# Autodesk Inventor assembly: SPE10V1 Soporte Freno (soldadura)
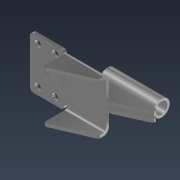
[picture p0: Inventor's stored thumbnail of the model, 180x180]
Saved by Autodesk Inventor 2021.2 (Build 252289000, 289)
## iProperties
Created: 2026-08-04
Part Number: SPE10V1 Soporte Freno (soldadura)
Document SubType Name: Assembly
Designer: nelso
Author: nelso
## Documents named in this file (4)
- C:\Users\Tecnica\OneDrive\Documentos\Mecanica\Soporte-Paciente-Espinografia\Workspace\SPE10V1 Soporte Freno (soldadura).iam
- C:\Users\Tecnica\OneDrive\Documentos\Mecanica\Soporte-Paciente-Espinografia\Workspace\SP32V1 Estructura Freno.ipt
- C:\Users\Tecnica\OneDrive\Documentos\Mecanica\Soporte-Paciente-Espinografia\Workspace\SP31V1 Columna Freno.ipt
- C:\Users\Tecnica\OneDrive\Documentos\Mecanica\Soporte-Paciente-Espinografia\Workspace\SP30V1 Camisa Freno.ipt
## Components (4 placed, 3 different names)
1. SP30V1 Camisa Freno:1 — Tangent:1
2. SP31V1 Columna Freno:1
3. SP31V1 Columna Freno:2 — Mate:3, Mate:4, Tangent:1
4. SP32V1 Estructura Freno:1 — Mate:3, Mate:4
## Relationships (6: Mate 4, Flush 1, Tangent 1)
- [Mate]: SP31V1 Columna Freno:1 ↔ SP32V1 Estructura Freno:1
- [Mate]: SP31V1 Columna Freno:1 ↔ SP32V1 Estructura Freno:1
- [Flush]: SP30V1 Camisa Freno:1 ↔ SP31V1 Columna Freno:1
- Mate:3: SP31V1 Columna Freno:2 ↔ SP32V1 Estructura Freno:1
- Mate:4: SP31V1 Columna Freno:2 ↔ SP32V1 Estructura Freno:1
- Tangent:1: SP30V1 Camisa Freno:1 ↔ SP31V1 Columna Freno:2
